# Autodesk Inventor assembly: Gimbal
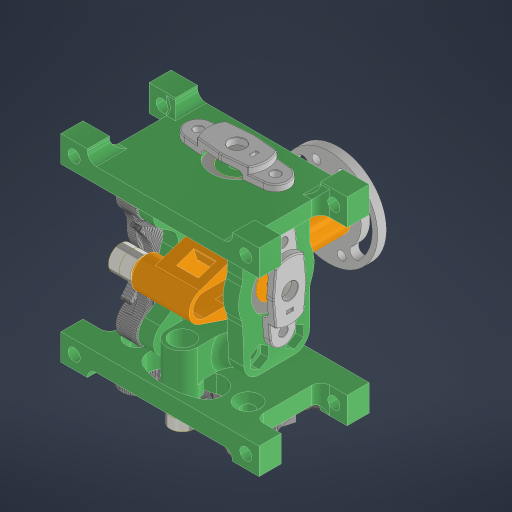
[picture p0: Inventor's stored thumbnail of the model, 512x512]
Saved by Autodesk Inventor 2023 (Build 270158000, 158)
## iProperties
Created: 2026-11-06
Part Number: Gimbal
Document SubType Name: Assembly
Designer: szykr
Author: szykr
## Documents named in this file (13)
- D:\Folder Instalacyjny\GitHub Pliki\HOTAS\Inventor\Gimbal\Gimbal.iam
- D:\Folder Instalacyjny\GitHub Pliki\HOTAS\Inventor\Gimbal\gimbal_cam.ipt
- D:\Folder Instalacyjny\GitHub Pliki\HOTAS\Inventor\Gimbal\gimbal_core_bearing_carrier.ipt
- D:\Folder Instalacyjny\GitHub Pliki\HOTAS\Inventor\Gimbal\gimbal_core_bearing_carrier_6802zz.ipt
- D:\Folder Instalacyjny\GitHub Pliki\HOTAS\Inventor\Gimbal\gimbal_core_non_pot_side.ipt
- D:\Folder Instalacyjny\GitHub Pliki\HOTAS\Inventor\Gimbal\gimbal_core_pot_side.ipt
- D:\Folder Instalacyjny\GitHub Pliki\HOTAS\Inventor\Gimbal\gimbal_frame.ipt
- D:\Folder Instalacyjny\GitHub Pliki\HOTAS\Inventor\Gimbal\gimbal_frame_6802zz.ipt
- D:\Folder Instalacyjny\GitHub Pliki\HOTAS\Inventor\gimbal2\Cam_modified.ipt
- D:\Folder Instalacyjny\GitHub Pliki\HOTAS\Inventor\Gimbal\lozyska\685ZZ_(618[slash]5).ipt
- D:\Folder Instalacyjny\GitHub Pliki\HOTAS\Inventor\Gimbal\lozyska\6802ZZ_61802.ipt
- D:\Folder Instalacyjny\GitHub Pliki\HOTAS\Inventor\Gimbal\Rod.iam
- D:\Folder Instalacyjny\GitHub Pliki\HOTAS\Inventor\Gimbal\Pot Holder.ipt
## Components (29 placed, 12 different names)
1. gimbal_cam:1 — Insert:11
2. gimbal_core_bearing_carrier:1 — Insert:2, Insert:3, Insert:4, Insert:5, Insert:35, Insert:38, Insert:39
3. gimbal_core_bearing_carrier_6802zz:1 — Insert:6, Insert:7, Insert:11, Insert:16, Insert:17, Insert:18
4. gimbal_core_non_pot_side:1 — Insert:2, Insert:3, Insert:7, Insert:9, Insert:23, Insert:31
5. gimbal_core_pot_side:1 — Insert:4, Insert:5, Insert:6, Insert:10, Insert:29
6. gimbal_frame:1 — Insert:10, Angle:2, Flush:1
7. gimbal_frame_6802zz:1 — Insert:9, Angle:1, Angle:2, Insert:14, Insert:15, Insert:19, Insert:20
8. gimbal_cam:2 — Insert:15
9. gimbal_cam:3 — Insert:14
10. gimbal_cam:4 — Insert:16
11. Cam_modified:1 — Insert:17, Insert:25
12. Cam_modified:2 — Insert:20, Insert:22
13. Cam_modified:3 — Insert:19, Insert:21
14. Cam_modified:4 — Insert:18, Insert:26
15. 685ZZ_(618[slash]5):1 — Insert:22
16. 685ZZ_(618[slash]5):2 — Insert:23, Insert:24
17. 685ZZ_(618[slash]5):3 — Insert:24
18. 685ZZ_(618[slash]5):4 — Insert:21
19. 685ZZ_(618[slash]5):5 — Insert:28
20. 685ZZ_(618[slash]5):6 — Insert:28
21. 685ZZ_(618[slash]5):7 — Insert:26
22. 685ZZ_(618[slash]5):8 — Insert:25
23. 6802ZZ_61802:1 — Insert:37
24. 6802ZZ_61802:2 — Insert:31
25. 6802ZZ_61802:3 — Insert:36
26. 6802ZZ_61802:4 — Insert:29
27. Rod:1 [sub-assembly] — Insert:35, Insert:36, Insert:37
28. Pot Holder:1 — Flush:1
29. Pot Holder:2 — Insert:38, Insert:39
## Relationships (33: Insert 30, Angle 2, Flush 1)
- Insert:2: gimbal_core_bearing_carrier:1 ↔ gimbal_core_non_pot_side:1
- Insert:3: gimbal_core_bearing_carrier:1 ↔ gimbal_core_non_pot_side:1
- Insert:4: gimbal_core_bearing_carrier:1 ↔ gimbal_core_pot_side:1
- Insert:5: gimbal_core_bearing_carrier:1 ↔ gimbal_core_pot_side:1
- Insert:6: gimbal_core_bearing_carrier_6802zz:1 ↔ gimbal_core_pot_side:1
- Insert:7: gimbal_core_bearing_carrier_6802zz:1 ↔ gimbal_core_non_pot_side:1
- Insert:9: gimbal_core_non_pot_side:1 ↔ gimbal_frame_6802zz:1
- Angle:1 (180 deg): gimbal_frame_6802zz:1
- Insert:10: gimbal_core_pot_side:1 ↔ gimbal_frame:1
- Angle:2 (0 deg): gimbal_frame:1 ↔ gimbal_frame_6802zz:1
- Insert:11: gimbal_cam:1 ↔ gimbal_core_bearing_carrier_6802zz:1
- Insert:14: gimbal_frame_6802zz:1 ↔ gimbal_cam:3
- Insert:15: gimbal_frame_6802zz:1 ↔ gimbal_cam:2
- Insert:16: gimbal_core_bearing_carrier_6802zz:1 ↔ gimbal_cam:4
- Insert:17: gimbal_core_bearing_carrier_6802zz:1 ↔ Cam_modified:1
- Insert:18: gimbal_core_bearing_carrier_6802zz:1 ↔ Cam_modified:4
- Insert:19: gimbal_frame_6802zz:1 ↔ Cam_modified:3
- Insert:20: gimbal_frame_6802zz:1 ↔ Cam_modified:2
- Insert:21: Cam_modified:3 ↔ 685ZZ_(618[slash]5):4
- Insert:22: Cam_modified:2 ↔ 685ZZ_(618[slash]5):1
- Insert:23: gimbal_core_non_pot_side:1 ↔ 685ZZ_(618[slash]5):2
- Insert:24: 685ZZ_(618[slash]5):2 ↔ 685ZZ_(618[slash]5):3
- Insert:25: Cam_modified:1 ↔ 685ZZ_(618[slash]5):8
- Insert:26: Cam_modified:4 ↔ 685ZZ_(618[slash]5):7
- Insert:28: 685ZZ_(618[slash]5):5 ↔ 685ZZ_(618[slash]5):6
- Insert:29: gimbal_core_pot_side:1 ↔ 6802ZZ_61802:4
- Insert:31: gimbal_core_non_pot_side:1 ↔ 6802ZZ_61802:2
- Insert:35: gimbal_core_bearing_carrier:1 ↔ Rod:1
- Insert:36: 6802ZZ_61802:3 ↔ Rod:1
- Insert:37: 6802ZZ_61802:1 ↔ Rod:1
- Flush:1: gimbal_frame:1 ↔ Pot Holder:1
- Insert:38: gimbal_core_bearing_carrier:1 ↔ Pot Holder:2
- Insert:39: gimbal_core_bearing_carrier:1 ↔ Pot Holder:2
